# Autodesk Inventor assembly: ASM_AxeEtRoues_Grobot_proto1
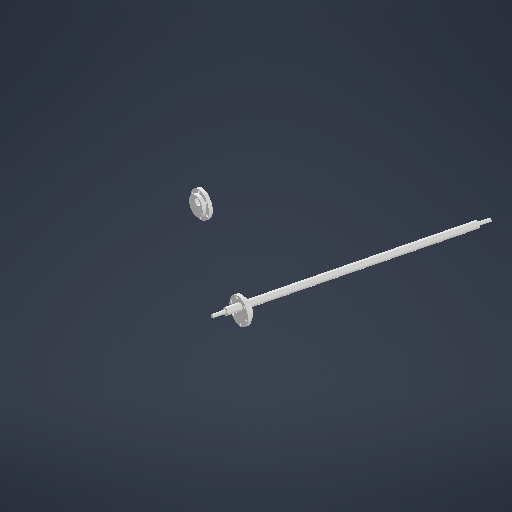
[picture p0: Inventor's stored thumbnail of the model, 512x512]
Saved by Autodesk Inventor 2026 (Build 300175050, 175E)
## iProperties
Created: 2025-05-12
Part Number: ASM_AxeEtRoues_Grobot_proto1
Document SubType Name: Assembly
Designer: Diogo
Author: Diogo
## Documents named in this file (3)
- C:\Users\karle\OneDrive - HESSO\P2511_Dossier_partage_RVEZ\01_Robot\0101_CAO\Moteur\ASM_AxeEtRoues_Grobot_proto1.iam
- C:\Users\karle\OneDrive - HESSO\P2511_Dossier_partage_RVEZ\01_Robot\0101_CAO\Moteur\Axe_Roues_arr_Grobot.ipt
- C:\Users\karle\OneDrive - HESSO\P2511_Dossier_partage_RVEZ\01_Robot\0101_CAO\Moteur\Adaptateur_Roulements_AxeRoues.ipt
## Components (3 placed, 2 different names)
1. Axe_Roues_arr_Grobot:1 — Passend:4
2. Adaptateur_Roulements_AxeRoues:1
3. Adaptateur_Roulements_AxeRoues:2 — Passend:4
## Relationships (1: Mate 1)
- Passend:4 [Mate]: Axe_Roues_arr_Grobot:1 ↔ Adaptateur_Roulements_AxeRoues:2
